# Autodesk Inventor assembly: Устройство_полностью
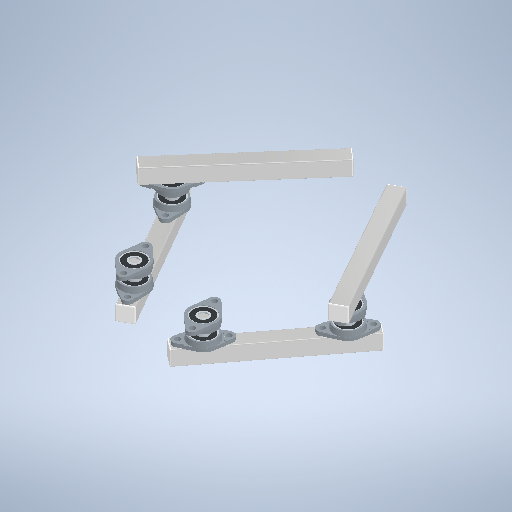
[picture p0: Inventor's stored thumbnail of the model, 512x512]
Saved by Autodesk Inventor 2025.1 (Build 291241000, 241)
## iProperties
Created: 2026-10-13
Part Number: Устройство_полностью
Document SubType Name: Assembly
Designer: Ваня
Author: Ваня
## Documents named in this file (5)
- C:\Users\Ваня\Desktop\SCARA_ETZ_2027\3D Модели\Сборки\Устройство_полностью.iam
- C:\Users\Ваня\Desktop\SCARA_ETZ_2027\3D Модели\Для сборки\Металл\Профиль_алюминиевый.ipt
- C:\Users\Ваня\Desktop\SCARA_ETZ_2027\3D Модели\Для сборки\Подшипники\pillow_block-KFL08\pillow_block-KFL08\pillow_block-KFL08.ipt
- C:\Users\Ваня\Desktop\SCARA_ETZ_2027\3D Модели\Для сборки\Металл\Вал_алюминиевый_8x20.ipt
- C:\Users\Ваня\Desktop\SCARA_ETZ_2027\3D Модели\Для печати\Заглушка_для_профиля.ipt
## Components (24 placed, 4 different names)
1. Профиль_алюминиевый:1 — С поворотом:3, С поворотом:4, Заподлицо:1, Жесткий:5, Жесткий:7, С поворотом:15, С поворотом:16
2. pillow_block-KFL08:1 — С поворотом:1, С поворотом:5, С поворотом:6
3. pillow_block-KFL08:2 — С поворотом:2, С поворотом:3, С поворотом:4
4. Вал_алюминиевый_8x20:1 — С поворотом:1, С поворотом:2
5. Профиль_алюминиевый:2 — С поворотом:5, С поворотом:6, Жесткий:3, Жесткий:6
6. Профиль_алюминиевый:3 — Жесткий:1, Жесткий:2
7. pillow_block-KFL08:3
8. pillow_block-KFL08:4
9. Вал_алюминиевый_8x20:2
10. Профиль_алюминиевый:4 — Заподлицо:1, Жесткий:4, Жесткий:8, С поворотом:19, С поворотом:20
11. Заглушка_для_профиля:1 — Жесткий:1
12. Заглушка_для_профиля:2 — Жесткий:4
13. Заглушка_для_профиля:3 — Жесткий:8
14. Заглушка_для_профиля:4 — Жесткий:5
15. Заглушка_для_профиля:5 — Жесткий:2
16. Заглушка_для_профиля:6 — Жесткий:3
17. Заглушка_для_профиля:7 — Жесткий:6
18. Заглушка_для_профиля:8 — Жесткий:7
19. pillow_block-KFL08:5 — С поворотом:15, С поворотом:16
20. pillow_block-KFL08:6
21. Вал_алюминиевый_8x20:3
22. pillow_block-KFL08:7 — С поворотом:19, С поворотом:20
23. pillow_block-KFL08:8
24. Вал_алюминиевый_8x20:4
## Relationships (29: RevoluteJoint 20, WeldJoint 8, Flush 1)
- С поворотом:1 [RevoluteJoint] (-10 mm): pillow_block-KFL08:1 ↔ Вал_алюминиевый_8x20:1
- С поворотом:2 [RevoluteJoint] (-10 mm): pillow_block-KFL08:2 ↔ Вал_алюминиевый_8x20:1
- С поворотом:3 [RevoluteJoint]: Профиль_алюминиевый:1 ↔ pillow_block-KFL08:2
- С поворотом:4 [RevoluteJoint]: Профиль_алюминиевый:1 ↔ pillow_block-KFL08:2
- С поворотом:5 [RevoluteJoint]: pillow_block-KFL08:1 ↔ Профиль_алюминиевый:2
- С поворотом:6 [RevoluteJoint]: pillow_block-KFL08:1 ↔ Профиль_алюминиевый:2
- [RevoluteJoint] (-10 mm): pillow_block-KFL08:3 ↔ Вал_алюминиевый_8x20:2
- [RevoluteJoint] (-10 mm): pillow_block-KFL08:4 ↔ Вал_алюминиевый_8x20:2
- [RevoluteJoint]: Профиль_алюминиевый:3 ↔ pillow_block-KFL08:4
- [RevoluteJoint]: Профиль_алюминиевый:3 ↔ pillow_block-KFL08:4
- [RevoluteJoint]: pillow_block-KFL08:3 ↔ Профиль_алюминиевый:4
- [RevoluteJoint]: pillow_block-KFL08:3 ↔ Профиль_алюминиевый:4
- Заподлицо:1 [Flush]: Профиль_алюминиевый:1 ↔ Профиль_алюминиевый:4
- Жесткий:1 [WeldJoint]: Профиль_алюминиевый:3 ↔ Заглушка_для_профиля:1
- Жесткий:2 [WeldJoint]: Профиль_алюминиевый:3 ↔ Заглушка_для_профиля:5
- Жесткий:3 [WeldJoint]: Профиль_алюминиевый:2 ↔ Заглушка_для_профиля:6
- Жесткий:4 [WeldJoint]: Профиль_алюминиевый:4 ↔ Заглушка_для_профиля:2
- Жесткий:5 [WeldJoint]: Профиль_алюминиевый:1 ↔ Заглушка_для_профиля:4
- Жесткий:6 [WeldJoint]: Профиль_алюминиевый:2 ↔ Заглушка_для_профиля:7
- Жесткий:7 [WeldJoint]: Профиль_алюминиевый:1 ↔ Заглушка_для_профиля:8
- Жесткий:8 [WeldJoint]: Профиль_алюминиевый:4 ↔ Заглушка_для_профиля:3
- [RevoluteJoint] (-10 mm): pillow_block-KFL08:5 ↔ Вал_алюминиевый_8x20:3
- [RevoluteJoint] (-10 mm): pillow_block-KFL08:6 ↔ Вал_алюминиевый_8x20:3
- С поворотом:15 [RevoluteJoint]: Профиль_алюминиевый:1 ↔ pillow_block-KFL08:5
- С поворотом:16 [RevoluteJoint]: Профиль_алюминиевый:1 ↔ pillow_block-KFL08:5
- [RevoluteJoint] (-10 mm): pillow_block-KFL08:7 ↔ Вал_алюминиевый_8x20:4
- [RevoluteJoint] (-10 mm): pillow_block-KFL08:8 ↔ Вал_алюминиевый_8x20:4
- С поворотом:19 [RevoluteJoint]: Профиль_алюминиевый:4 ↔ pillow_block-KFL08:7
- С поворотом:20 [RevoluteJoint]: Профиль_алюминиевый:4 ↔ pillow_block-KFL08:7
## Named parameters: d12_d0 = -10 mm, d13_d1 = 56.520592 deg, d14_d2 = -10 mm, d15_d3 = -169.869276 deg, d16_d4 = 0 mm, d17_d5 = -117.758992 deg, d18_d6 = 0 mm, d19_d7 = -62.241008 deg, d20_d8 = 0 mm, d21_d9 = 117.758992 deg, d22_d10 = 0 mm, d23_d11 = 117.758992 deg, d33_d12_d0 = -10 mm, d34_d13_d1 = -9.164475 deg, d35_d14_d2 = -10 mm, d36_d15_d3 = 179.033153 deg, d41_d12_d0 = -10 mm, d42_d13_d1 = 85.728303 deg, d43_d14_d2 = -10 mm, d44_d15_d3 = 151.474995 deg
